# Autodesk Inventor assembly: End Effector Platform
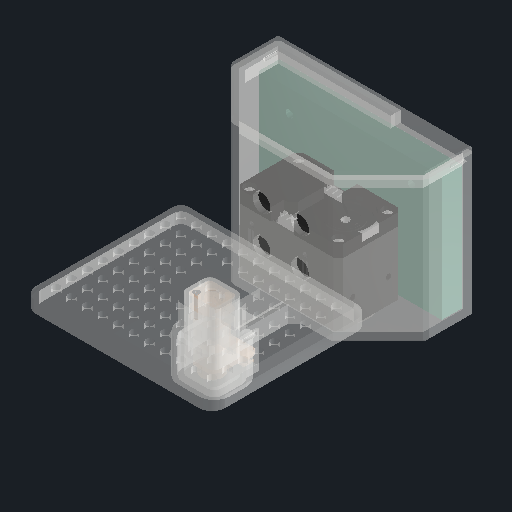
[picture p0: Inventor's stored thumbnail of the model, 512x512]
Saved by Autodesk Inventor 2027.1 (Build 311270010, 270A)
## iProperties
Created: 2026-08-17
Part Number: End Effector Platform
Document SubType Name: Assembly
Designer: Oasis
Author: Oasis
## Documents named in this file (8)
- C:\Users\anshi\Desktop\school\1P13\Design Studio\proj1 cad1\finalparts\ReferencePlatform\End Effector Platform - rotating shaft reference.iam
- C:\Users\anshi\Desktop\school\1P13\Design Studio\proj1 cad1\finalparts\ReferencePlatform\End Effector Platform Base.ipt
- C:\Users\anshi\Desktop\school\1P13\Design Studio\proj1 cad1\finalparts\ReferencePlatform\End Effector Platform Compartment Lid.ipt
- C:\Users\anshi\Desktop\school\1P13\Design Studio\proj1 cad1\finalparts\ReferencePlatform\End Effector Platform.ipt
- C:\Users\anshi\Desktop\school\1P13\Design Studio\proj1 cad1\finalparts\ReferencePlatform\Gripper Motor Cover.ipt
- C:\Users\anshi\Desktop\school\1P13\Design Studio\proj1 cad1\finalparts\ReferencePlatform\XC-430_idle v3.iam
- C:\Users\anshi\Desktop\school\1P13\Design Studio\proj1 cad1\finalparts\ReferencePlatform\Quanser QUARC EE Board.ipt
- C:\Users\anshi\Desktop\school\1P13\Design Studio\proj1 cad1\finalparts\ReferencePlatform\N20 stationary motor reference.ipt
## Components (7 placed, 7 different names)
1. End Effector Platform Base:1 — Mate:1, Mate:2, Mate:3, Mate:4, Mate:5, Mate:6, Flush:1, Flush:2, Mate:7, Mate:10, Mate:11, Mate:12, Mate:13, Mate:14
2. End Effector Platform Compartment Lid:1 — Flush:1, Flush:2, Mate:7
3. End Effector Platform:1 — Mate:10, Mate:11, Mate:12, Mate:15
4. Gripper Motor Cover:1 — Mate:13, Mate:14, Mate:15
5. N20 stationary motor reference:1
6. XC-430_idle v3:1 [sub-assembly] — Mate:1, Mate:2, Mate:3
7. Quanser QUARC EE Board:1 — Mate:4, Mate:5, Mate:6
## Relationships (18: Mate 15, Flush 3)
- Mate:1: End Effector Platform Base:1 ↔ XC-430_idle v3:1
- Mate:2: End Effector Platform Base:1 ↔ XC-430_idle v3:1
- Mate:3: End Effector Platform Base:1 ↔ XC-430_idle v3:1
- Mate:4: End Effector Platform Base:1 ↔ Quanser QUARC EE Board:1
- Mate:5: End Effector Platform Base:1 ↔ Quanser QUARC EE Board:1
- Mate:6: End Effector Platform Base:1 ↔ Quanser QUARC EE Board:1
- Flush:1: End Effector Platform Base:1 ↔ End Effector Platform Compartment Lid:1
- Flush:2: End Effector Platform Base:1 ↔ End Effector Platform Compartment Lid:1
- Mate:7: End Effector Platform Base:1 ↔ End Effector Platform Compartment Lid:1
- [Mate] (0.2 mm): End Effector Platform Base:1 ↔ N20 stationary motor reference:1
- [Mate] (0.2 mm): End Effector Platform Base:1 ↔ N20 stationary motor reference:1
- [Flush]: End Effector Platform Base:1 ↔ N20 stationary motor reference:1
- Mate:10 (0.1 mm): End Effector Platform Base:1 ↔ End Effector Platform:1
- Mate:11 (0.1 mm): End Effector Platform Base:1 ↔ End Effector Platform:1
- Mate:12: End Effector Platform Base:1 ↔ End Effector Platform:1
- Mate:13 (0.01 mm): End Effector Platform Base:1 ↔ Gripper Motor Cover:1
- Mate:14 (0.01 mm): End Effector Platform Base:1 ↔ Gripper Motor Cover:1
- Mate:15: End Effector Platform:1 ↔ Gripper Motor Cover:1
